# Autodesk Inventor assembly: ASSEMBLY_HTD3M_Idler_B_Axis_Top
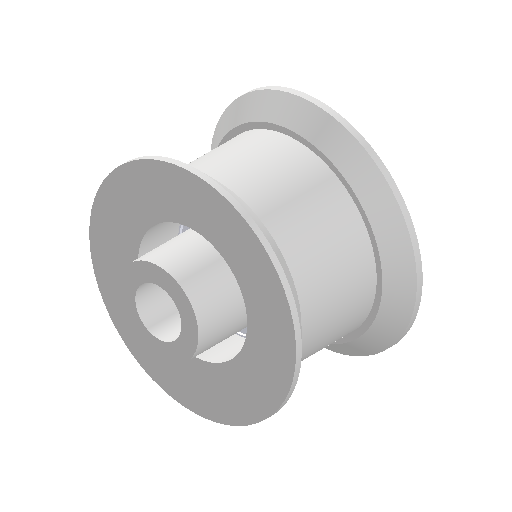
[picture p0: Inventor's stored thumbnail of the model, 512x512]
Saved by Autodesk Inventor 2027 (Build 310192060, 192F)
## iProperties
Created: 2026-01-06
Part Number: ASSEMBLY_HTD3M_Idler_B_Axis_Top
Document SubType Name: Assembly
Designer: User
Author: User
## Documents named in this file (5)
- C:\Users\lacze\OneDrive\_DRIVE_SYNCH_FILES\RF - Antenna Positioner\MCAD\1_V1\ASSEMBLY_DUT_ANT_POSITIONER_REVA\ASSEMBLY_HTD3M_Idler_B_Axis_Top.iam
- C:\Users\lacze\OneDrive\_DRIVE_SYNCH_FILES\RF - Antenna Positioner\MCAD\1_V1\ASSEMBLY_DUT_ANT_POSITIONER_REVA\3DP_PLA_HTD3M_6mm_Belt_Idler.ipt
- C:\Users\lacze\OneDrive\_DRIVE_SYNCH_FILES\RF - Antenna Positioner\MCAD\1_V1\ASSEMBLY_DUT_ANT_POSITIONER_REVA\3DP_PLA_HTD3M_6mm_Belt_Idler_Top_Cover.ipt
- C:\Users\lacze\OneDrive\_DRIVE_SYNCH_FILES\RF - Antenna Positioner\MCAD\1_V1\ASSEMBLY_DUT_ANT_POSITIONER_REVA\3DP_PLA_HTD3M_6mm_Belt_Idler_Bottom_Washer_B_Axis_Top.ipt
- C:\Users\lacze\OneDrive\_DRIVE_SYNCH_FILES\RF - Antenna Positioner\MCAD\1_V1\__COTS_PARTS\COTS_GENERIC_604H_2RS_4x12x4mm_Ceramic_Ball_Bearing.ipt
## Components (5 placed, 4 different names)
1. 3DP_PLA_HTD3M_6mm_Belt_Idler:1 — Mate:2, Mate:3, Mate:4, Mate:7, Mate:8
2. COTS_GENERIC_604H_2RS_4x12x4mm_Ceramic_Ball_Bearing:1 — Mate:2, Mate:7, Mate:9, Mate:10, Mate:11, Mate:12
3. 3DP_PLA_HTD3M_6mm_Belt_Idler_Top_Cover:1 — Mate:3, Mate:4
4. 3DP_PLA_HTD3M_6mm_Belt_Idler_Bottom_Washer_B_Axis_Top:1 — Mate:9, Mate:12
5. 3DP_PLA_HTD3M_6mm_Belt_Idler_Bottom_Washer_B_Axis_Top:2 — Mate:10, Mate:11
## Relationships (9: Mate 9)
- Mate:2: 3DP_PLA_HTD3M_6mm_Belt_Idler:1 ↔ COTS_GENERIC_604H_2RS_4x12x4mm_Ceramic_Ball_Bearing:1
- Mate:3: 3DP_PLA_HTD3M_6mm_Belt_Idler:1 ↔ 3DP_PLA_HTD3M_6mm_Belt_Idler_Top_Cover:1
- Mate:4: 3DP_PLA_HTD3M_6mm_Belt_Idler:1 ↔ 3DP_PLA_HTD3M_6mm_Belt_Idler_Top_Cover:1
- Mate:7: 3DP_PLA_HTD3M_6mm_Belt_Idler:1 ↔ COTS_GENERIC_604H_2RS_4x12x4mm_Ceramic_Ball_Bearing:1
- Mate:8: 3DP_PLA_HTD3M_6mm_Belt_Idler:1
- Mate:9: COTS_GENERIC_604H_2RS_4x12x4mm_Ceramic_Ball_Bearing:1 ↔ 3DP_PLA_HTD3M_6mm_Belt_Idler_Bottom_Washer_B_Axis_Top:1
- Mate:10: COTS_GENERIC_604H_2RS_4x12x4mm_Ceramic_Ball_Bearing:1 ↔ 3DP_PLA_HTD3M_6mm_Belt_Idler_Bottom_Washer_B_Axis_Top:2
- Mate:11: COTS_GENERIC_604H_2RS_4x12x4mm_Ceramic_Ball_Bearing:1 ↔ 3DP_PLA_HTD3M_6mm_Belt_Idler_Bottom_Washer_B_Axis_Top:2
- Mate:12: COTS_GENERIC_604H_2RS_4x12x4mm_Ceramic_Ball_Bearing:1 ↔ 3DP_PLA_HTD3M_6mm_Belt_Idler_Bottom_Washer_B_Axis_Top:1
